# Autodesk Inventor assembly: Assembly1
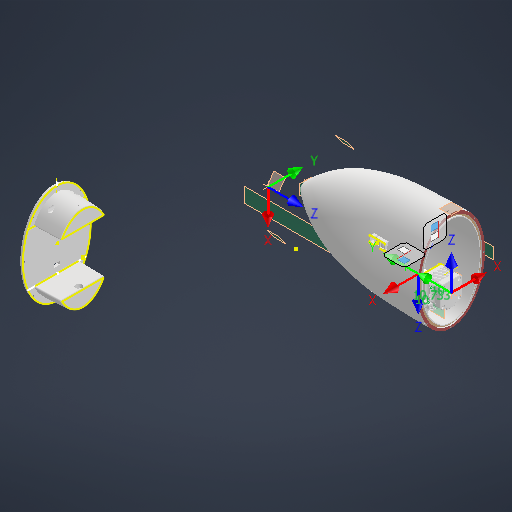
[picture p0: Inventor's stored thumbnail of the model, 512x512]
Saved by Autodesk Inventor 2027 (Build 310192060, 192F)
## iProperties
Created: 2026-06-12
Part Number: Assembly1
Document SubType Name: Assembly
Designer: thita
Author: thita
## Documents named in this file (11)
- D:\Year2\đồ án tốt nghịp\new fish\DESIGN_VIT_ME\Workgroups\new\Assembly1.iam
- D:\Year2\đồ án tốt nghịp\new fish\DESIGN_VIT_ME\Workgroups\new\DESIGN\Workgroups\NotInProject\NotInProject\DAU.ipt
- D:\Year2\đồ án tốt nghịp\new fish\DESIGN_VIT_ME\Workgroups\new\GP2Y0A02YK0F SHARP.ipt
- D:\Year2\đồ án tốt nghịp\new fish\DESIGN_VIT_ME\Workgroups\new\Khối pin sạc Li-ion 12V 21Ah 30A 3S MTM.ipt
- D:\Year2\đồ án tốt nghịp\new fish\DESIGN_VIT_ME\Workgroups\new\DESIGN\Workgroups\NotInProject\NotInProject\NAP.ipt
- D:\Year2\đồ án tốt nghịp\new fish\DESIGN_VIT_ME\Workgroups\new\Step - Nema 17 - 17HS4401S - Usongshine.ipt
- D:\Year2\đồ án tốt nghịp\new fish\DESIGN_VIT_ME\Workgroups\new\2040ALUMINIUM PROFIL 35CM_MIR.ipt
- D:\Year2\đồ án tốt nghịp\new fish\DESIGN_VIT_ME\Workgroups\new\Gia_truc_z.ipt
- D:\Year2\đồ án tốt nghịp\new fish\DESIGN_VIT_ME\Workgroups\new\5mm to 8mm rigid shaft coupler v2.ipt
- D:\Year2\đồ án tốt nghịp\new fish\DESIGN_VIT_ME\Workgroups\new\vitme-t8-buoc2.ipt
- D:\Year2\đồ án tốt nghịp\new fish\DESIGN_VIT_ME\Workgroups\new\Goi Do Dai Oc.ipt
## Components (11 placed, 10 different names)
1. DAU:1 — Mate:4, Mate:5, Mate:6, Mate:7, Flush:1
2. GP2Y0A02YK0F SHARP:1 — Mate:6, Mate:7
3. GP2Y0A02YK0F SHARP:2 — Mate:4, Mate:5
4. Khối pin sạc Li-ion 12V 21Ah 30A 3S MTM:1 — Mate:22, Flush:2
5. NAP:1
6. 2040ALUMINIUM PROFIL 35CM_MIR:1 — Mate:15, Mate:23, Mate:26
7. Step - Nema 17 - 17HS4401S - Usongshine:2 — Rigid:6, Rotational:2, Flush:1
8. Goi Do Dai Oc:1 — Mate:22, Flush:2, Mate:24, Mate:25, Mate:26
9. Gia_truc_z:1 — Rigid:6, Mate:15, Mate:23
10. 5mm to 8mm rigid shaft coupler v2:1 — Rotational:2, Rigid:7
11. vitme-t8-buoc2:1 — Rigid:7, Mate:24, Mate:25
## Relationships (15: Mate 10, WeldJoint 2, Flush 2, RevoluteJoint 1)
- Mate:4: DAU:1 ↔ GP2Y0A02YK0F SHARP:2
- Mate:5: DAU:1 ↔ GP2Y0A02YK0F SHARP:2
- Mate:6: DAU:1 ↔ GP2Y0A02YK0F SHARP:1
- Mate:7: DAU:1 ↔ GP2Y0A02YK0F SHARP:1
- Rigid:6 [WeldJoint]: Step - Nema 17 - 17HS4401S - Usongshine:2 ↔ Gia_truc_z:1
- Rotational:2 [RevoluteJoint] (-10 mm): Step - Nema 17 - 17HS4401S - Usongshine:2 ↔ 5mm to 8mm rigid shaft coupler v2:1
- Rigid:7 [WeldJoint] (-5 mm): 5mm to 8mm rigid shaft coupler v2:1 ↔ vitme-t8-buoc2:1
- Mate:15: 2040ALUMINIUM PROFIL 35CM_MIR:1 ↔ Gia_truc_z:1
- Mate:22 (3 mm): Khối pin sạc Li-ion 12V 21Ah 30A 3S MTM:1 ↔ Goi Do Dai Oc:1
- Mate:23: 2040ALUMINIUM PROFIL 35CM_MIR:1 ↔ Gia_truc_z:1
- Flush:1: DAU:1 ↔ Step - Nema 17 - 17HS4401S - Usongshine:2
- Flush:2 (-20 mm): Khối pin sạc Li-ion 12V 21Ah 30A 3S MTM:1 ↔ Goi Do Dai Oc:1
- Mate:24: Goi Do Dai Oc:1 ↔ vitme-t8-buoc2:1
- Mate:25: Goi Do Dai Oc:1 ↔ vitme-t8-buoc2:1
- Mate:26 (9.328 mm): 2040ALUMINIUM PROFIL 35CM_MIR:1 ↔ Goi Do Dai Oc:1
## Named parameters: Finish2_Area = 9.80067, Finish3_Area = 16.8006, Finish4_Area = 23.6105, Finish5_Area = 23.6105, Finish6_Area = 1.06717
note: some values were not read from the file. Shown as the stored number, unit unknown: "Finish2_Area", "Finish3_Area", "Finish4_Area", "Finish5_Area", "Finish6_Area".
